# Autodesk Inventor assembly: ASSEMBLY_Main
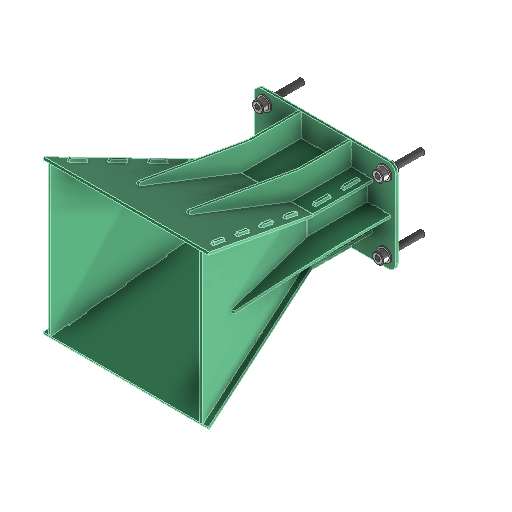
[picture p0: Inventor's stored thumbnail of the model, 512x512]
Saved by Autodesk Inventor 2026.1 (Build 301233000, 233)
## iProperties
Created: 2025-11-04
Part Number: ASSEMBLY_Main
Document SubType Name: Assembly
Designer: User
Author: User
## Documents named in this file (16)
- C:\Users\Andrzej\OneDrive\_DRIVE_SYNCH_FILES\RFC - #4 PCB Coaxial Feed Horn Antenna (3-7 GHz)\MCAD\2_FR4_PANELS_TAB_AND_SLOT\ASSEMBLY_MAIN_REVA\ASSEMBLY_Main.iam
- C:\Users\Andrzej\OneDrive\_DRIVE_SYNCH_FILES\RFC - #4 PCB Coaxial Feed Horn Antenna (3-7 GHz)\MCAD\2_FR4_PANELS_TAB_AND_SLOT\ASSEMBLY_MAIN_REVA\CUT_FR4_Horn_Top_Bottom_Plate.ipt
- C:\Users\Andrzej\OneDrive\_DRIVE_SYNCH_FILES\RFC - #4 PCB Coaxial Feed Horn Antenna (3-7 GHz)\MCAD\2_FR4_PANELS_TAB_AND_SLOT\ASSEMBLY_MAIN_REVA\CUT_FR4_Horn_Left_Right_Plate.ipt
- C:\Users\Andrzej\OneDrive\_DRIVE_SYNCH_FILES\RFC - #4 PCB Coaxial Feed Horn Antenna (3-7 GHz)\MCAD\2_FR4_PANELS_TAB_AND_SLOT\__CST_EXPORTED\CST_3D_MODEL.ipt
- C:\Users\Andrzej\OneDrive\_DRIVE_SYNCH_FILES\RFC - #4 PCB Coaxial Feed Horn Antenna (3-7 GHz)\MCAD\2_FR4_PANELS_TAB_AND_SLOT\ASSEMBLY_MAIN_REVA\CUT_FR4_Waveguide_Side_Plate.ipt
- C:\Users\Andrzej\OneDrive\_DRIVE_SYNCH_FILES\RFC - #4 PCB Coaxial Feed Horn Antenna (3-7 GHz)\MCAD\2_FR4_PANELS_TAB_AND_SLOT\ASSEMBLY_MAIN_REVA\CUT_FR4_Waveguide_Bottom_Plate.ipt
- C:\Users\Andrzej\OneDrive\_DRIVE_SYNCH_FILES\RFC - #4 PCB Coaxial Feed Horn Antenna (3-7 GHz)\MCAD\2_FR4_PANELS_TAB_AND_SLOT\ASSEMBLY_MAIN_REVA\CUT_FR4_Waveguide_Top_Plate.ipt
- C:\Users\Andrzej\OneDrive\_DRIVE_SYNCH_FILES\RFC - #4 PCB Coaxial Feed Horn Antenna (3-7 GHz)\MCAD\2_FR4_PANELS_TAB_AND_SLOT\ASSEMBLY_MAIN_REVA\CUT_FR4_Waveguide_Back_Plate.ipt
- C:\Users\Andrzej\OneDrive\_DRIVE_SYNCH_FILES\RFC - #4 PCB Coaxial Feed Horn Antenna (3-7 GHz)\MCAD\2_FR4_PANELS_TAB_AND_SLOT\__CONTENT_CENTER_PARTS\en-US\DIN 912\DIN 912 - M2,5 x 0,45 x 5 x 3,875.ipt
- C:\Users\Andrzej\OneDrive\_DRIVE_SYNCH_FILES\RFC - #4 PCB Coaxial Feed Horn Antenna (3-7 GHz)\MCAD\2_FR4_PANELS_TAB_AND_SLOT\__CONTENT_CENTER_PARTS\en-US\DIN 125-1  A\DIN 125 - A 4,3.ipt
- C:\Users\Andrzej\OneDrive\_DRIVE_SYNCH_FILES\RFC - #4 PCB Coaxial Feed Horn Antenna (3-7 GHz)\MCAD\2_FR4_PANELS_TAB_AND_SLOT\__CONTENT_CENTER_PARTS\en-US\DIN 934\DIN 934 - M4 x 0,7.ipt
- C:\Users\Andrzej\OneDrive\_DRIVE_SYNCH_FILES\RFC - #4 PCB Coaxial Feed Horn Antenna (3-7 GHz)\MCAD\2_FR4_PANELS_TAB_AND_SLOT\__CONTENT_CENTER_PARTS\en-US\DIN 912\DIN 912 - M4 x 0,7 x 25 x 23,25.ipt
- C:\Users\Andrzej\OneDrive\_DRIVE_SYNCH_FILES\RFC - #4 PCB Coaxial Feed Horn Antenna (3-7 GHz)\MCAD\2_FR4_PANELS_TAB_AND_SLOT\ASSEMBLY_MAIN_REVA\CUT_FR4_Stiffening_Rib_Top_Bot.ipt
- C:\Users\Andrzej\OneDrive\_DRIVE_SYNCH_FILES\RFC - #4 PCB Coaxial Feed Horn Antenna (3-7 GHz)\MCAD\2_FR4_PANELS_TAB_AND_SLOT\ASSEMBLY_MAIN_REVA\CUT_FR4_Stiffening_Rib_Left_Right.ipt
- C:\Users\Andrzej\OneDrive\_DRIVE_SYNCH_FILES\RFC - #4 PCB Coaxial Feed Horn Antenna (3-7 GHz)\MCAD\2_FR4_PANELS_TAB_AND_SLOT\__COTS_PARTS\COTS_AMPHENOL_901-2PF705590AM_SMA_Connector\COTS_AMPHENOL_901-2PF705590AM_SMA_Connector_SIM.iam
- C:\Users\Andrzej\OneDrive\_DRIVE_SYNCH_FILES\RFC - #4 PCB Coaxial Feed Horn Antenna (3-7 GHz)\MCAD\2_FR4_PANELS_TAB_AND_SLOT\__CONTENT_CENTER_PARTS\en-US\DIN 439-2\DIN 439 - M2,5 x 0,45.ipt
## Components (41 placed, 15 different names)
1. CUT_FR4_Horn_Top_Bottom_Plate:1 — Flush:3, Mate:1, Mate:2, Mate:7, Mate:8, Mate:50, Mate:52
2. CUT_FR4_Horn_Top_Bottom_Plate:2 — Flush:4, Mate:3, Mate:4, Mate:5, Mate:6, Mate:13
3. CUT_FR4_Horn_Left_Right_Plate:1 — Flush:1, Mate:1, Mate:4, Mate:6, Mate:7, Mate:53
4. CUT_FR4_Horn_Left_Right_Plate:2 — Flush:2, Mate:2, Mate:3, Mate:5, Mate:8
5. CST_3D_MODEL:1 — Flush:1, Flush:2, Flush:3, Flush:4
6. CUT_FR4_Waveguide_Side_Plate:1 — Mate:9, Flush:6, Mate:12, Mate:14, Mate:53, Mate:64
7. CUT_FR4_Waveguide_Bottom_Plate:1 — Mate:9, Mate:10, Flush:5, Flush:6, Mate:11, Mate:12, Mate:13, Flush:7, Flush:8, Flush:9, Flush:10, Mate:60, Mate:61
8. CUT_FR4_Waveguide_Side_Plate:2 — Mate:10, Flush:5, Mate:11, Mate:65
9. CUT_FR4_Waveguide_Top_Plate:1 — Mate:14, Flush:7, Flush:8, Mate:15, Mate:50, Mate:52, Mate:54, Mate:56, Mate:68, Mate:69, Mate:70, Angle:1, Mate:82, Mate:84, Mate:86, Mate:88
10. CUT_FR4_Waveguide_Back_Plate:1 — Mate:15, Flush:9, Flush:10, Mate:34, Mate:35, Mate:36, Mate:37, Mate:38, Mate:39, Mate:40, Mate:41, Mate:42, Mate:43, Mate:44, Mate:45, Mate:46, Mate:47, Mate:48, Mate:49, Mate:55, Mate:57, Mate:62, Mate:63, Mate:66, Mate:67, Mate:89, Mate:90, Mate:91
11. COTS_AMPHENOL_901-2PF705590AM_SMA_Connector_SIM:1 [sub-assembly] — Mate:69, Mate:70, Mate:71, Mate:72, Angle:1, Mate:73, Mate:74, Mate:75, Mate:76, Mate:77, Mate:78, Mate:79, Mate:80, Mate:81, Mate:83, Mate:85, Mate:87
12. CUT_FR4_Stiffening_Rib_Top_Bot:1 — Mate:54, Mate:55, Flush:12, Mate:72
13. CUT_FR4_Stiffening_Rib_Top_Bot:2 — Mate:56, Mate:57, Flush:11, Mate:71
14. CUT_FR4_Stiffening_Rib_Top_Bot:3 — Mate:61, Mate:63, Flush:11
15. CUT_FR4_Stiffening_Rib_Top_Bot:4 — Mate:60, Mate:62, Flush:12
16. CUT_FR4_Stiffening_Rib_Left_Right:1 — Mate:64, Mate:67, Mate:68, Flush:13
17. CUT_FR4_Stiffening_Rib_Left_Right:2 — Mate:65, Mate:66, Flush:13
18. DIN 439-2 - replaced by DIN EN 24035/28675 M2,5:4 — Mate:87, Mate:88
19. DIN 439-2 - replaced by DIN EN 24035/28675 M2,5:3 — Mate:85, Mate:86
20. DIN 439-2 - replaced by DIN EN 24035/28675 M2,5:2 — Mate:83, Mate:84
21. DIN 912 - replaced by DIN EN ISO 4762 M2,5 x 5:4 — Mate:79, Mate:80
22. DIN 912 - replaced by DIN EN ISO 4762 M2,5 x 5:3 — Mate:77, Mate:78
23. DIN 912 - replaced by DIN EN ISO 4762 M2,5 x 5:2 — Mate:75, Mate:76
24. DIN 439-2 - replaced by DIN EN 24035/28675 M2,5:1 — Mate:81, Mate:82
25. DIN 912 - replaced by DIN EN ISO 4762 M2,5 x 5:1 — Mate:73, Mate:74
26. DIN 125-1 A A 4,3:1 — Mate:34, Mate:35, Insert:1
27. DIN 912 - replaced by DIN EN ISO 4762 M4 x 25:1 — Insert:1
28. DIN 125-1 A A 4,3:2 — Mate:42, Mate:43, Insert:5
29. DIN 934 - replaced by DIN EN 24032/28673/28674 M4:1 — Insert:5
30. DIN 125-1 A A 4,3:3 — Mate:36, Mate:37, Insert:2
31. DIN 125-1 A A 4,3:4 — Mate:38, Mate:39, Insert:3
32. DIN 125-1 A A 4,3:5 — Mate:40, Mate:41, Insert:4
33. DIN 912 - replaced by DIN EN ISO 4762 M4 x 25:2 — Insert:2
34. DIN 912 - replaced by DIN EN ISO 4762 M4 x 25:3 — Insert:3
35. DIN 912 - replaced by DIN EN ISO 4762 M4 x 25:4 — Insert:4
36. DIN 125-1 A A 4,3:6 — Mate:44, Mate:45, Insert:6
37. DIN 125-1 A A 4,3:7 — Mate:46, Mate:47, Insert:7
38. DIN 125-1 A A 4,3:8 — Mate:48, Mate:49, Insert:8
39. DIN 934 - replaced by DIN EN 24032/28673/28674 M4:2 — Insert:6
40. DIN 934 - replaced by DIN EN 24032/28673/28674 M4:3 — Insert:7
41. DIN 934 - replaced by DIN EN 24032/28673/28674 M4:4 — Insert:8
## Relationships (92: Mate 70, Flush 13, Insert 8, Angle 1)
- Flush:1: CUT_FR4_Horn_Left_Right_Plate:1 ↔ CST_3D_MODEL:1
- Flush:2: CUT_FR4_Horn_Left_Right_Plate:2 ↔ CST_3D_MODEL:1
- Flush:3: CUT_FR4_Horn_Top_Bottom_Plate:1 ↔ CST_3D_MODEL:1
- Flush:4: CUT_FR4_Horn_Top_Bottom_Plate:2 ↔ CST_3D_MODEL:1
- Mate:1: CUT_FR4_Horn_Top_Bottom_Plate:1 ↔ CUT_FR4_Horn_Left_Right_Plate:1
- Mate:2: CUT_FR4_Horn_Top_Bottom_Plate:1 ↔ CUT_FR4_Horn_Left_Right_Plate:2
- Mate:3: CUT_FR4_Horn_Top_Bottom_Plate:2 ↔ CUT_FR4_Horn_Left_Right_Plate:2
- Mate:4: CUT_FR4_Horn_Top_Bottom_Plate:2 ↔ CUT_FR4_Horn_Left_Right_Plate:1
- Mate:5 (5 mm): CUT_FR4_Horn_Top_Bottom_Plate:2 ↔ CUT_FR4_Horn_Left_Right_Plate:2
- Mate:6 (5 mm): CUT_FR4_Horn_Top_Bottom_Plate:2 ↔ CUT_FR4_Horn_Left_Right_Plate:1
- Mate:7 (5 mm): CUT_FR4_Horn_Top_Bottom_Plate:1 ↔ CUT_FR4_Horn_Left_Right_Plate:1
- Mate:8 (5 mm): CUT_FR4_Horn_Top_Bottom_Plate:1 ↔ CUT_FR4_Horn_Left_Right_Plate:2
- Mate:9: CUT_FR4_Waveguide_Side_Plate:1 ↔ CUT_FR4_Waveguide_Bottom_Plate:1
- Mate:10: CUT_FR4_Waveguide_Bottom_Plate:1 ↔ CUT_FR4_Waveguide_Side_Plate:2
- Flush:5: CUT_FR4_Waveguide_Bottom_Plate:1 ↔ CUT_FR4_Waveguide_Side_Plate:2
- Flush:6: CUT_FR4_Waveguide_Side_Plate:1 ↔ CUT_FR4_Waveguide_Bottom_Plate:1
- Mate:11 (-5 mm): CUT_FR4_Waveguide_Bottom_Plate:1 ↔ CUT_FR4_Waveguide_Side_Plate:2
- Mate:12 (-5 mm): CUT_FR4_Waveguide_Side_Plate:1 ↔ CUT_FR4_Waveguide_Bottom_Plate:1
- Mate:13: CUT_FR4_Horn_Top_Bottom_Plate:2 ↔ CUT_FR4_Waveguide_Bottom_Plate:1
- Mate:14: CUT_FR4_Waveguide_Side_Plate:1 ↔ CUT_FR4_Waveguide_Top_Plate:1
- Flush:7: CUT_FR4_Waveguide_Bottom_Plate:1 ↔ CUT_FR4_Waveguide_Top_Plate:1
- Flush:8: CUT_FR4_Waveguide_Bottom_Plate:1 ↔ CUT_FR4_Waveguide_Top_Plate:1
- Mate:15: CUT_FR4_Waveguide_Top_Plate:1 ↔ CUT_FR4_Waveguide_Back_Plate:1
- Flush:9 (-15 mm): CUT_FR4_Waveguide_Bottom_Plate:1 ↔ CUT_FR4_Waveguide_Back_Plate:1
- Flush:10 (-15 mm): CUT_FR4_Waveguide_Bottom_Plate:1 ↔ CUT_FR4_Waveguide_Back_Plate:1
- Mate:34: CUT_FR4_Waveguide_Back_Plate:1 ↔ DIN 125-1 A A 4,3:1
- Mate:35: CUT_FR4_Waveguide_Back_Plate:1 ↔ DIN 125-1 A A 4,3:1
- Mate:36: CUT_FR4_Waveguide_Back_Plate:1 ↔ DIN 125-1 A A 4,3:3
- Mate:37: CUT_FR4_Waveguide_Back_Plate:1 ↔ DIN 125-1 A A 4,3:3
- Mate:38: CUT_FR4_Waveguide_Back_Plate:1 ↔ DIN 125-1 A A 4,3:4
- Mate:39: CUT_FR4_Waveguide_Back_Plate:1 ↔ DIN 125-1 A A 4,3:4
- Mate:40: CUT_FR4_Waveguide_Back_Plate:1 ↔ DIN 125-1 A A 4,3:5
- Mate:41: CUT_FR4_Waveguide_Back_Plate:1 ↔ DIN 125-1 A A 4,3:5
- Insert:1: DIN 125-1 A A 4,3:1 ↔ DIN 912 - replaced by DIN EN ISO 4762 M4 x 25:1
- Insert:2: DIN 125-1 A A 4,3:3 ↔ DIN 912 - replaced by DIN EN ISO 4762 M4 x 25:2
- Insert:3: DIN 125-1 A A 4,3:4 ↔ DIN 912 - replaced by DIN EN ISO 4762 M4 x 25:3
- Insert:4: DIN 125-1 A A 4,3:5 ↔ DIN 912 - replaced by DIN EN ISO 4762 M4 x 25:4
- Mate:42: CUT_FR4_Waveguide_Back_Plate:1 ↔ DIN 125-1 A A 4,3:2
- Mate:43: CUT_FR4_Waveguide_Back_Plate:1 ↔ DIN 125-1 A A 4,3:2
- Mate:44: CUT_FR4_Waveguide_Back_Plate:1 ↔ DIN 125-1 A A 4,3:6
- Mate:45: CUT_FR4_Waveguide_Back_Plate:1 ↔ DIN 125-1 A A 4,3:6
- Mate:46: CUT_FR4_Waveguide_Back_Plate:1 ↔ DIN 125-1 A A 4,3:7
- Mate:47: CUT_FR4_Waveguide_Back_Plate:1 ↔ DIN 125-1 A A 4,3:7
- Mate:48: CUT_FR4_Waveguide_Back_Plate:1 ↔ DIN 125-1 A A 4,3:8
- Mate:49: CUT_FR4_Waveguide_Back_Plate:1 ↔ DIN 125-1 A A 4,3:8
- Insert:5: DIN 125-1 A A 4,3:2 ↔ DIN 934 - replaced by DIN EN 24032/28673/28674 M4:1
- Insert:6: DIN 125-1 A A 4,3:6 ↔ DIN 934 - replaced by DIN EN 24032/28673/28674 M4:2
- Insert:7: DIN 125-1 A A 4,3:7 ↔ DIN 934 - replaced by DIN EN 24032/28673/28674 M4:3
- Insert:8: DIN 125-1 A A 4,3:8 ↔ DIN 934 - replaced by DIN EN 24032/28673/28674 M4:4
- Mate:50: CUT_FR4_Horn_Top_Bottom_Plate:1 ↔ CUT_FR4_Waveguide_Top_Plate:1
- Mate:52: CUT_FR4_Horn_Top_Bottom_Plate:1 ↔ CUT_FR4_Waveguide_Top_Plate:1
- Mate:53: CUT_FR4_Horn_Left_Right_Plate:1 ↔ CUT_FR4_Waveguide_Side_Plate:1
- Mate:54: CUT_FR4_Waveguide_Top_Plate:1 ↔ CUT_FR4_Stiffening_Rib_Top_Bot:1
- Mate:55: CUT_FR4_Waveguide_Back_Plate:1 ↔ CUT_FR4_Stiffening_Rib_Top_Bot:1
- Mate:56: CUT_FR4_Waveguide_Top_Plate:1 ↔ CUT_FR4_Stiffening_Rib_Top_Bot:2
- Mate:57: CUT_FR4_Waveguide_Back_Plate:1 ↔ CUT_FR4_Stiffening_Rib_Top_Bot:2
- Mate:60: CUT_FR4_Waveguide_Bottom_Plate:1 ↔ CUT_FR4_Stiffening_Rib_Top_Bot:4
- Mate:61: CUT_FR4_Waveguide_Bottom_Plate:1 ↔ CUT_FR4_Stiffening_Rib_Top_Bot:3
- Mate:62: CUT_FR4_Waveguide_Back_Plate:1 ↔ CUT_FR4_Stiffening_Rib_Top_Bot:4
- Mate:63: CUT_FR4_Waveguide_Back_Plate:1 ↔ CUT_FR4_Stiffening_Rib_Top_Bot:3
- Flush:11: CUT_FR4_Stiffening_Rib_Top_Bot:2 ↔ CUT_FR4_Stiffening_Rib_Top_Bot:3
- Flush:12: CUT_FR4_Stiffening_Rib_Top_Bot:1 ↔ CUT_FR4_Stiffening_Rib_Top_Bot:4
- Mate:64: CUT_FR4_Waveguide_Side_Plate:1 ↔ CUT_FR4_Stiffening_Rib_Left_Right:1
- Mate:65: CUT_FR4_Waveguide_Side_Plate:2 ↔ CUT_FR4_Stiffening_Rib_Left_Right:2
- Mate:66: CUT_FR4_Waveguide_Back_Plate:1 ↔ CUT_FR4_Stiffening_Rib_Left_Right:2
- Mate:67: CUT_FR4_Waveguide_Back_Plate:1 ↔ CUT_FR4_Stiffening_Rib_Left_Right:1
- Mate:68 (12.6 mm): CUT_FR4_Waveguide_Top_Plate:1 ↔ CUT_FR4_Stiffening_Rib_Left_Right:1
- Flush:13: CUT_FR4_Stiffening_Rib_Left_Right:1 ↔ CUT_FR4_Stiffening_Rib_Left_Right:2
- Mate:69: CUT_FR4_Waveguide_Top_Plate:1 ↔ COTS_AMPHENOL_901-2PF705590AM_SMA_Connector_SIM:1
- Mate:70: CUT_FR4_Waveguide_Top_Plate:1 ↔ COTS_AMPHENOL_901-2PF705590AM_SMA_Connector_SIM:1
- Mate:71 (9 mm): COTS_AMPHENOL_901-2PF705590AM_SMA_Connector_SIM:1 ↔ CUT_FR4_Stiffening_Rib_Top_Bot:2
- Mate:72 (9 mm): COTS_AMPHENOL_901-2PF705590AM_SMA_Connector_SIM:1 ↔ CUT_FR4_Stiffening_Rib_Top_Bot:1
- Angle:1 (0 deg): CUT_FR4_Waveguide_Top_Plate:1 ↔ COTS_AMPHENOL_901-2PF705590AM_SMA_Connector_SIM:1
- Mate:73: COTS_AMPHENOL_901-2PF705590AM_SMA_Connector_SIM:1 ↔ DIN 912 - replaced by DIN EN ISO 4762 M2,5 x 5:1
- Mate:74: COTS_AMPHENOL_901-2PF705590AM_SMA_Connector_SIM:1 ↔ DIN 912 - replaced by DIN EN ISO 4762 M2,5 x 5:1
- Mate:75: COTS_AMPHENOL_901-2PF705590AM_SMA_Connector_SIM:1 ↔ DIN 912 - replaced by DIN EN ISO 4762 M2,5 x 5:2
- Mate:76: COTS_AMPHENOL_901-2PF705590AM_SMA_Connector_SIM:1 ↔ DIN 912 - replaced by DIN EN ISO 4762 M2,5 x 5:2
- Mate:77: COTS_AMPHENOL_901-2PF705590AM_SMA_Connector_SIM:1 ↔ DIN 912 - replaced by DIN EN ISO 4762 M2,5 x 5:3
- Mate:78: COTS_AMPHENOL_901-2PF705590AM_SMA_Connector_SIM:1 ↔ DIN 912 - replaced by DIN EN ISO 4762 M2,5 x 5:3
- Mate:79: COTS_AMPHENOL_901-2PF705590AM_SMA_Connector_SIM:1 ↔ DIN 912 - replaced by DIN EN ISO 4762 M2,5 x 5:4
- Mate:80: COTS_AMPHENOL_901-2PF705590AM_SMA_Connector_SIM:1 ↔ DIN 912 - replaced by DIN EN ISO 4762 M2,5 x 5:4
- Mate:81: COTS_AMPHENOL_901-2PF705590AM_SMA_Connector_SIM:1 ↔ DIN 439-2 - replaced by DIN EN 24035/28675 M2,5:1
- Mate:82: CUT_FR4_Waveguide_Top_Plate:1 ↔ DIN 439-2 - replaced by DIN EN 24035/28675 M2,5:1
- Mate:83: COTS_AMPHENOL_901-2PF705590AM_SMA_Connector_SIM:1 ↔ DIN 439-2 - replaced by DIN EN 24035/28675 M2,5:2
- Mate:84: CUT_FR4_Waveguide_Top_Plate:1 ↔ DIN 439-2 - replaced by DIN EN 24035/28675 M2,5:2
- Mate:85: COTS_AMPHENOL_901-2PF705590AM_SMA_Connector_SIM:1 ↔ DIN 439-2 - replaced by DIN EN 24035/28675 M2,5:3
- Mate:86: CUT_FR4_Waveguide_Top_Plate:1 ↔ DIN 439-2 - replaced by DIN EN 24035/28675 M2,5:3
- Mate:87: COTS_AMPHENOL_901-2PF705590AM_SMA_Connector_SIM:1 ↔ DIN 439-2 - replaced by DIN EN 24035/28675 M2,5:4
- Mate:88: CUT_FR4_Waveguide_Top_Plate:1 ↔ DIN 439-2 - replaced by DIN EN 24035/28675 M2,5:4
- Mate:89 (-30 mm): CUT_FR4_Waveguide_Back_Plate:1
- Mate:90 (-45.9 mm): CUT_FR4_Waveguide_Back_Plate:1
- Mate:91: CUT_FR4_Waveguide_Back_Plate:1
